# Autodesk Inventor assembly: MM0948AN100_G40_001
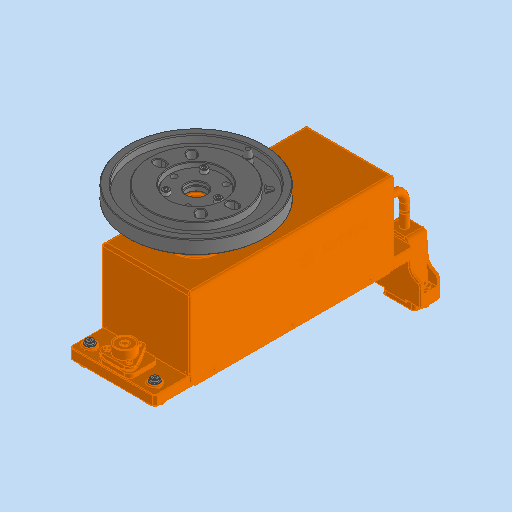
[picture p0: Inventor's stored thumbnail of the model, 512x512]
Saved by Autodesk Inventor 2023.3 (Build 273359000, 359)
## iProperties
RuleStatus: InUse
Created: 2023-03-23
Part Number: MM0948AN100_G40_001
Description: =<RBPARTNOTITLE2>
Document SubType Name: Assembly
Designer: FH/Wi
Mass: 550.693 g
Surface Area: 310.674 cm^2
Volume: 70.152 cm^3
Density: 7.85 g/cm^3
AnP_Kategorie: 99
AnP_Material: =<Material>
AnP_TemplVers: 20200821
RBDOCUMENTTYPE: DRF
RBDOCUMENTVERSION: 00
RBDRAWINGMAINSCALE: 1:1
RBDRAWINGMISSINGSPEC: --
RBDRAWINGVOLUME: --
RBDSV1: 0850
RBGBEDGESIN1: +0,5
RBGBEDGESIN2: +0,2
RBGBEDGESOUT1: -0,3
RBGBEDGESOUT2: -0,1
RBMATERIAL: =<Material>
RBMATMEETS: --
RBMATNO: =<Part Number>
RBPARTMADEOF: --
RBPARTNO: SIEHE MNR
RBPARTNOTITLE1: Scale
RBPARTNOTITLE2: Waage
RBPARTSAFETYINDICATOR: --
RBSURFACE: --
RBSURFACE2: --
RBZEDGESNORM: ISO13715:2002-06
RBZGENDIMCLASS: m
RBZGENDIMNORM: ISO 2768-1:1989-11
RBZGENGEOCLASS: H
RBZGENGEONORM: ISO 2768-2:1989-11
RBZSURFACENORM: ISO13D2:2002-02
RBZTOLERANCENORM: ISO 14405-1:2010-12
Author: FH/Wi
Keywords: =<RBPARTMADEOF>
Comments: =<RBSURFACE2>
Revision Number: 01
## Documents named in this file (9)
- C:\Users\rea9an\Documents\Inventor\TCAI2412_te1910_EM\AS00000936.iam
- C:\Users\rea9an\Documents\Inventor\TCAI2412_te1910_EM\PT00004817.ipt
- C:\Users\rea9an\Documents\Inventor\TCAI2412_te1910_EM\PT00004858.ipt
- C:\Users\rea9an\Documents\Inventor\TCAI2412_te1910_EM\PT00004607.ipt
- C:\Users\rea9an\Documents\Inventor\TCAI2412_te1910_EM\PT00004608.ipt
- C:\Users\rea9an\Documents\Inventor\TCAI2412_te1910_EM\PT00004777.ipt
- C:\Users\rea9an\Documents\Inventor\TCAI2412_te1910_EM\PT00004838.ipt
- C:\Users\rea9an\Documents\Inventor\TCAI2412_te1910_EM\PT00004865.ipt
- C:\Users\rea9an\Documents\Inventor\TCAI2412_te1910_EM\PT00004624.ipt
## Components (14 placed, 8 different names)
1. PT00004607:2 — Einfügen:17, Winkel:2
2. PT00004608:2 — Einfügen:15, Passend:20, Passend:21, Passend:22
3. PT00004865:1 — Einfügen:18
4. PT00004858:4 — Passend:19
5. PT00004858:5
6. PT00004858:6 — Einfügen:15
7. PT00004624:1 — Einfügen:16, Winkel:1, Einfügen:17, Winkel:2, Einfügen:18, Passend:22
8. PT00004838:3 — Einfügen:10
9. PT00004777:3 — Einfügen:10
10. PT00004838:2 — Einfügen:12
11. PT00004777:2 — Einfügen:12
12. PT00004838:1 — Einfügen:11
13. PT00004777:1 — Einfügen:11
14. PT00004817:1 — Passend:19, Passend:20, Passend:21, Einfügen:16
## Relationships (20: Insert 10, Mate 8, Angle 2)
- [Insert]: PT00004777:2 ↔ PT00004817:1
- [Insert]: PT00004777:1 ↔ PT00004817:1
- [Insert]: PT00004777:3 ↔ PT00004817:1
- Einfügen:10 [Insert]: PT00004838:3 ↔ PT00004777:3
- Einfügen:11 [Insert]: PT00004838:1 ↔ PT00004777:1
- Einfügen:12 [Insert]: PT00004838:2 ↔ PT00004777:2
- [Mate]: PT00004608:2 ↔ PT00004858:6
- [Mate]: PT00004608:2 ↔ PT00004858:4
- [Mate]: PT00004608:2 ↔ PT00004858:5
- [Mate]: PT00004608:2 ↔ PT00004858:5
- Passend:19 [Mate]: PT00004858:4 ↔ PT00004817:1
- Einfügen:15 [Insert]: PT00004608:2 ↔ PT00004858:6
- Passend:20 [Mate]: PT00004608:2 ↔ PT00004817:1
- Passend:21 [Mate]: PT00004608:2 ↔ PT00004817:1
- Einfügen:16 [Insert]: PT00004624:1 ↔ PT00004817:1
- Winkel:1 [Angle] (0 deg): PT00004624:1
- Einfügen:17 [Insert]: PT00004607:2 ↔ PT00004624:1
- Winkel:2 [Angle] (180 deg): PT00004607:2 ↔ PT00004624:1
- Einfügen:18 [Insert]: PT00004865:1 ↔ PT00004624:1
- Passend:22 [Mate]: PT00004608:2 ↔ PT00004624:1
## Named parameters: d22_d21 = 0 mm, d28_d603 = 0 mm, d29_d604 = 0 mm, d30_d605 = 0 mm
